# Autodesk Inventor assembly: ThighLink_Passive_Right_Assembly
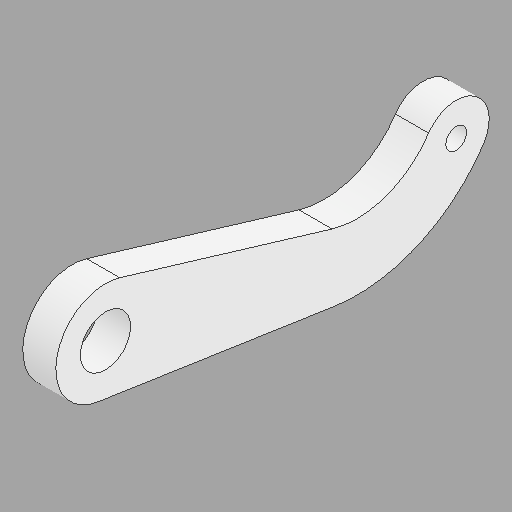
[picture p0: Inventor's stored thumbnail of the model, 512x512]
Saved by Autodesk Inventor 2025 (Build 290162000, 162)
## iProperties
Created: 2024-11-15
Part Number: ThighLink_Passive_Right_Assembly
Document SubType Name: Assembly
Designer: OSB
Mass: 39.2614 g
Surface Area: 146.442 cm^2
Volume: 34.8696 cm^3
Density: 1.12595 g/cm^3
Sending System: Autodesk Inventor 2021
Preprocessor: unknown
Minimum Resolution: 0.01
Sent Units: Millimeter
Translation Standard: IGES 5.3
Model Creation Time: 2020-07-07
Title: S500 Frame
Author: OSB
## Documents named in this file (7)
- C:\Users\OSB\Desktop\SB\1.Projects\캡스톤 디자인(2)_Paper\Modeling\Implementation_Design\Ver_003_mass_update\ThighLink_Passive_Right_Assembly_Collision.iam
- C:\Users\OSB\Desktop\SB\1.Projects\캡스톤 디자인(2)_Paper\Modeling\Implementation_Design\Ver_003_mass_update\ThighLink_Passive_Right.ipt
- C:\Users\OSB\Desktop\SB\1.Projects\캡스톤 디자인(2)_Paper\Modeling\Implementation_Design\Ver_003_mass_update\ShoulderBolt.ipt
- C:\Users\OSB\Desktop\SB\1.Projects\캡스톤 디자인(2)_Paper\Modeling\Implementation_Design\Ver_003_mass_update\Washer_6x12.5x1.ipt
- C:\Users\OSB\Documents\Inventor\Content Center Files\R2025\ko-KR\KS B 2023\KS B 2023 - 696 - 6 x 15 x 5 - 1.132.ipt
- C:\Users\OSB\Desktop\SB\1.Projects\캡스톤 디자인(2)_Paper\Modeling\Implementation_Design\Ver_003_mass_update\Spacer_Joint_Assembly.ipt.iam
- Spacer_Joint_Assembly.ipt
## Components (7 placed, 5 different names)
1. ThighLink_Passive_Right:1 — 강체:4, 강체:8
2. ShoulderBolt:1 — 강체:4
3. Spacer_Joint_Assembly.ipt:1 [sub-assembly] — 강체:9
4. Washer_6x12.5x1:1 — 강체:6, 강체:9
5. Washer_6x12.5x1:2 — 강체:7, 강체:8
6. KS B 2023 696 - 6 x 15 x 5:1 — 강체:5, 강체:7
7. KS B 2023 696 - 6 x 15 x 5:2 — 강체:5, 강체:6
## Relationships (6: WeldJoint 6)
- 강체:4 [WeldJoint]: ThighLink_Passive_Right:1 ↔ ShoulderBolt:1
- 강체:5 [WeldJoint]: KS B 2023 696 - 6 x 15 x 5:1 ↔ KS B 2023 696 - 6 x 15 x 5:2
- 강체:6 [WeldJoint]: Washer_6x12.5x1:1 ↔ KS B 2023 696 - 6 x 15 x 5:2
- 강체:7 [WeldJoint]: Washer_6x12.5x1:2 ↔ KS B 2023 696 - 6 x 15 x 5:1
- 강체:8 [WeldJoint]: ThighLink_Passive_Right:1 ↔ Washer_6x12.5x1:2
- 강체:9 [WeldJoint]: Spacer_Joint_Assembly.ipt:1 ↔ Washer_6x12.5x1:1
